# Autodesk Inventor assembly: MM0861AN200_G24_802
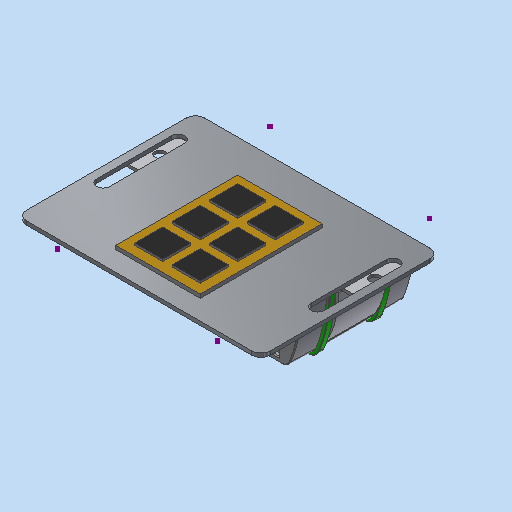
[picture p0: Inventor's stored thumbnail of the model, 512x512]
Saved by Autodesk Inventor 2023.3 (Build 273359000, 359)
## iProperties
Part Number: MM0861AN200_G24_802
Material: Generisch
Description: =<RBPARTNOTITLE2>
Document SubType Name: Assembly
Designer: Benutzer
Mass: 62.1488 g
Surface Area: 244.551 cm^2
Volume: 23.0266 cm^3
Density: 2.699 g/cm^3
RBCHANGEDESCRIPTION1: Erstfreigabe
RBCHANGENO1: 00
RBDOCUMENTTYPE: DRF
RBDOCUMENTVERSION: 00
RBDRAWINGMAINSCALE: 1:1
RBDRAWINGMISSINGSPEC: --
RBDRAWINGVOLUME: --
RBDSV1: 0850
RBGBDETAILS: 43274
RBGBEDGESIN1: +0,5
RBGBEDGESIN2: +0,2
RBGBEDGESOUT1: -0,3
RBGBEDGESOUT2: -0,1
RBMATERIAL: =<Material>
RBMATMEETS: --
RBMATNO: =<Part Number>
RBORGUNITRESPONSIBLE1: AnP/TEF1
RBPARTMADEOF: --
RBPARTNO: SIEHE MNR
RBPARTNOTITLE1: holder for controls
RBPARTNOTITLE2: Halter Bedienpanel
RBPARTSAFETYINDICATOR: --
RBSURFACE: --
RBSURFACE2: --
RBZEDGESNORM: ISO13715:2002-06
RBZGENDIMCLASS: m
RBZGENDIMNORM: ISO 2768-1:1989-11
RBZGENGEOCLASS: H
RBZGENGEONORM: ISO 2768-2:1989-11
RBZSURFACENORM: ISO13D2:2002-02
RBZTOLERANCENORM: ISO 14405-1:2010-12
AnP_Kommentar: --
MaxAbmaße: --
AnP_TemplVers: 20190222
AnP_Kategorie: 98
AnP_Material: =<Material>
Author: Benutzer
Keywords: =<RBPARTMADEOF>
Comments: =<RBSURFACE2>
Revision Number: 01
## Documents named in this file (3)
- C:\Users\rea9an\Documents\Inventor\TCAI2412_te1910_EM\AS00000900.iam
- C:\Users\rea9an\Documents\Inventor\TCAI2412_te1910_EM\PT00004484.ipt
- C:\Users\rea9an\Documents\Inventor\TCAI2412_te1910_EM\AS00000901.iam
## Components (2 placed, 2 different names)
1. PT00004484:1 — Fluchtend:1, Fluchtend:2, Passend:1
2. AS00000901:1 [sub-assembly] — Fluchtend:1, Fluchtend:2, Passend:1
## Relationships (3: Flush 2, Mate 1)
- Fluchtend:1 [Flush] (18.6 mm): PT00004484:1 ↔ AS00000901:1
- Fluchtend:2 [Flush] (64.55 mm): PT00004484:1 ↔ AS00000901:1
- Passend:1 [Mate]: PT00004484:1 ↔ AS00000901:1
